# Autodesk Inventor assembly: hole-csink
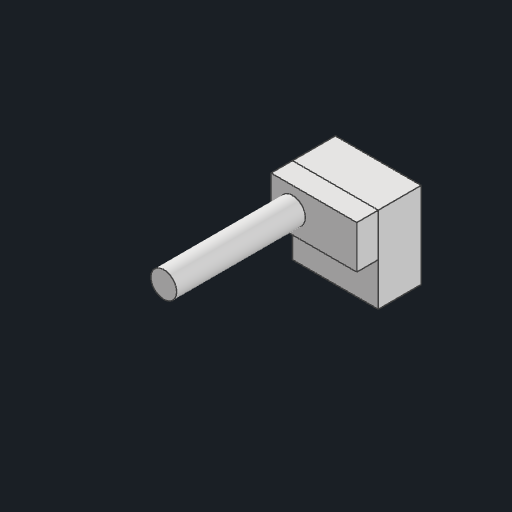
[picture p0: Inventor's stored thumbnail of the model, 512x512]
Saved by Autodesk Inventor 2026.1 (Build 301233000, 233)
## iProperties
Created: 2026-10-30
Part Number: hole-csink
Document SubType Name: Assembly
Designer: anony
Author: anony
## Documents named in this file (4)
- C:\Users\anony\OneDrive\Desktop\AI Projects\CAD Convert\corpus\generated\asmgrip\hole-csink.iam
- C:\Users\anony\OneDrive\Desktop\AI Projects\CAD Convert\corpus\generated\asmparts\box.ipt
- C:\Users\anony\OneDrive\Desktop\AI Projects\CAD Convert\corpus\generated\asmparts\pin.ipt
- C:\Users\anony\OneDrive\Desktop\AI Projects\CAD Convert\corpus\generated\hole\csink.ipt
## Components (3 placed, 3 different names)
1. box:1 — Mate:3, Mate:4, Mate:5, Mate:6, Mate:7, Mate:8, Mate:9, Mate:10, Mate:11, Mate:12, Mate:13, Mate:14, Mate:15, Mate:16, Mate:17, Mate:18, Mate:19
2. pin:1 — Mate:1, Mate:2, Insert:1, Insert:2, Insert:3
3. csink:1 — Mate:1, Mate:2, Mate:3, Mate:4, Mate:5, Mate:6, Mate:7, Mate:8, Mate:9, Insert:1, Insert:2, Insert:3, Mate:10, Mate:11, Mate:12, Mate:13, Mate:14, Mate:15, Mate:16, Mate:17, Mate:18, Mate:19
## Relationships (22: Mate 19, Insert 3)
- Mate:1: pin:1 ↔ csink:1
- Mate:2: pin:1 ↔ csink:1
- Mate:3: box:1 ↔ csink:1
- Mate:4: box:1 ↔ csink:1
- Mate:5: box:1 ↔ csink:1
- Mate:6: box:1 ↔ csink:1
- Mate:7: box:1 ↔ csink:1
- Mate:8: box:1 ↔ csink:1
- Mate:9: box:1 ↔ csink:1
- Insert:1: pin:1 ↔ csink:1
- Insert:2: pin:1 ↔ csink:1
- Insert:3: pin:1 ↔ csink:1
- Mate:10: box:1 ↔ csink:1
- Mate:11: box:1 ↔ csink:1
- Mate:12: box:1 ↔ csink:1
- Mate:13: box:1 ↔ csink:1
- Mate:14: box:1 ↔ csink:1
- Mate:15: box:1 ↔ csink:1
- Mate:16: box:1 ↔ csink:1
- Mate:17: box:1 ↔ csink:1
- Mate:18: box:1 ↔ csink:1
- Mate:19: box:1 ↔ csink:1
